# Autodesk Inventor assembly: Assembly1
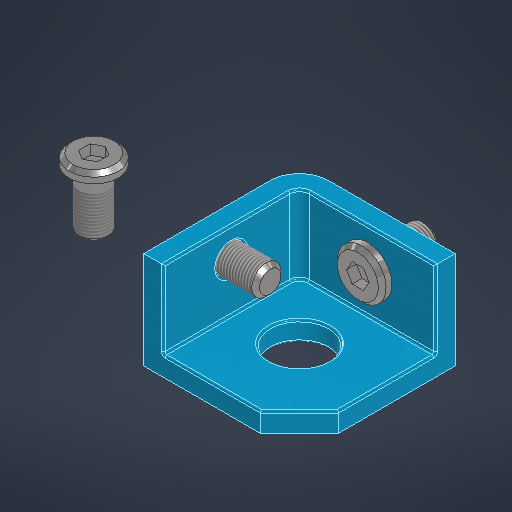
[picture p0: Inventor's stored thumbnail of the model, 512x512]
Saved by Autodesk Inventor 2026.4 (Build 304435000, 435)
## iProperties
Created: 2026-11-08
Part Number: Assembly1
Document SubType Name: Assembly
Designer: HP
Author: HP
## Documents named in this file (3)
- C:\Users\HP\Desktop\Projects\EAH_JENA\CAD_Training\1_Konstruktion\Assembly1.iam
- C:\Users\HP\Desktop\Projects\EAH_JENA\CAD_Training\1_Konstruktion\Youtube_example.ipt
- C:\Users\HP\Desktop\Projects\EAH_JENA\CAD_Training\1_Konstruktion\Youtube_bolt_eg.ipt
## Components (4 placed, 2 different names)
1. Youtube_example:1 — Mate:1, Mate:2, Angle:1, Mate:3, Mate:4, Angle:2
2. Youtube_bolt_eg:1
3. Youtube_bolt_eg:2 — Mate:3, Mate:4, Angle:2
4. Youtube_bolt_eg:3 — Mate:1, Mate:2, Angle:1
## Relationships (6: Mate 4, Angle 2)
- Mate:1: Youtube_example:1 ↔ Youtube_bolt_eg:3
- Mate:2: Youtube_example:1 ↔ Youtube_bolt_eg:3
- Angle:1 (0 deg): Youtube_example:1 ↔ Youtube_bolt_eg:3
- Mate:3: Youtube_example:1 ↔ Youtube_bolt_eg:2
- Mate:4: Youtube_example:1 ↔ Youtube_bolt_eg:2
- Angle:2 (0 deg): Youtube_example:1 ↔ Youtube_bolt_eg:2
